# Autodesk Inventor assembly: robotfish_new_1
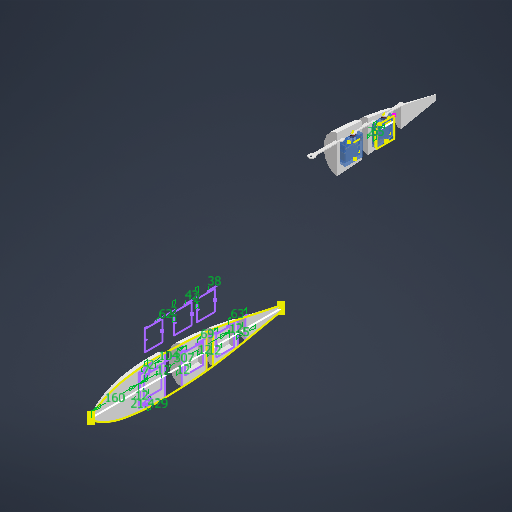
[picture p0: Inventor's stored thumbnail of the model, 512x512]
Saved by Autodesk Inventor 2027 (Build 310192060, 192F)
## iProperties
Created: 2026-08-14
Part Number: robotfish_new_1
Document SubType Name: Assembly
Designer: thita
Author: thita
## Documents named in this file (9)
- D:\Year2\đồ án tốt nghịp\đồ án tốt nghiệp v2\robotfish_new (3)\Workgroups\NotInProject\robotfish_new_1.iam
- D:\Year2\đồ án tốt nghịp\đồ án tốt nghiệp v2\robotfish_new (3)\Workgroups\NotInProject\main_body.ipt
- D:\Year2\đồ án tốt nghịp\đồ án tốt nghiệp v2\robotfish_new (3)\Workgroups\NotInProject\tail.ipt
- D:\Year2\đồ án tốt nghịp\đồ án tốt nghiệp v2\robotfish_new (3)\Workgroups\NotInProject\Assembly1.iam
- D:\Year2\đồ án tốt nghịp\đồ án tốt nghiệp v2\robotfish_new (3)\Workgroups\NotInProject\segment2.ipt
- D:\Year2\đồ án tốt nghịp\đồ án tốt nghiệp v2\robotfish_new (3)\Workgroups\NotInProject\segment3.ipt
- D:\Year2\đồ án tốt nghịp\đồ án tốt nghiệp v2\robotfish_new (3)\Workgroups\NotInProject\thanh lk.ipt
- D:\Year2\đồ án tốt nghịp\đồ án tốt nghiệp v2\robotfish_new (3)\Workgroups\NotInProject\thanh lk 1.ipt
- D:\Year2\đồ án tốt nghịp\đồ án tốt nghiệp v2\robotfish_new (3)\Workgroups\NotInProject\thanh lk 2.ipt
## Components (9 placed, 8 different names)
1. main_body:1
2. Assembly1:10 [sub-assembly] — Rigid:2, Rigid:4
3. Assembly1:11 [sub-assembly] — Rigid:3, Rigid:5, Rotational:1
4. segment2:1 — Rigid:2
5. segment3:1 — Rigid:3
6. thanh lk:1 — Rigid:4
7. thanh lk 1:1 — Rigid:5
8. thanh lk 2:1 — Rotational:1
9. tail:1
## Relationships (5: WeldJoint 4, RevoluteJoint 1)
- Rigid:2 [WeldJoint]: Assembly1:10 ↔ segment2:1
- Rigid:3 [WeldJoint]: Assembly1:11 ↔ segment3:1
- Rigid:4 [WeldJoint]: Assembly1:10 ↔ thanh lk:1
- Rigid:5 [WeldJoint]: Assembly1:11 ↔ thanh lk 1:1
- Rotational:1 [RevoluteJoint]: Assembly1:11 ↔ thanh lk 2:1
